# Autodesk Inventor assembly: ascunde teavaAssembly1
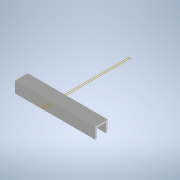
[picture p0: Inventor's stored thumbnail of the model, 180x180]
Saved by Autodesk Inventor 2022.6 (Build 266554000, 554)
## iProperties
Created: 2026-11-09
Part Number: ascunde teavaAssembly1
Document SubType Name: Assembly
Designer: Dragos Macovei
Author: Dragos Macovei
## Documents named in this file (3)
- C:\Users\Dragos Macovei\Documents\3D_Parts\PAT ADI\ascunde teavaAssembly1.iam
- C:\Users\Dragos Macovei\Documents\3D_Parts\PAT ADI\ascuns_teava_1.ipt
- C:\Users\Dragos Macovei\Documents\3D_Parts\PAT ADI\ascuns_teava_2.ipt
## Components (3 placed, 2 different names)
1. ascuns_teava_1:1 — Flush:1, Flush:2, Flush:5
2. ascuns_teava_1:2 — Flush:1, Flush:2, Flush:3, Flush:4, Flush:6
3. ascuns_teava_2:1 — Flush:3, Flush:4, Flush:5, Flush:6
## Relationships (6: Flush 6)
- Flush:1: ascuns_teava_1:1 ↔ ascuns_teava_1:2
- Flush:2: ascuns_teava_1:1 ↔ ascuns_teava_1:2
- Flush:3: ascuns_teava_1:2 ↔ ascuns_teava_2:1
- Flush:4: ascuns_teava_1:2 ↔ ascuns_teava_2:1
- Flush:5: ascuns_teava_1:1 ↔ ascuns_teava_2:1
- Flush:6: ascuns_teava_1:2 ↔ ascuns_teava_2:1
